# Autodesk Inventor assembly: 組合7
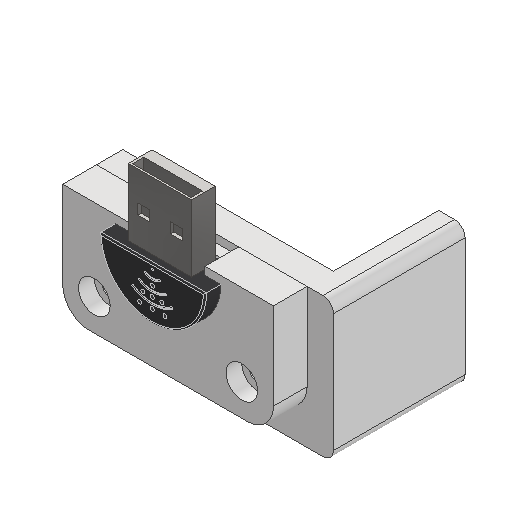
[picture p0: Inventor's stored thumbnail of the model, 512x512]
Saved by Autodesk Inventor 2027 (Build 310192060, 192F)
## iProperties
Created: 2026-11-23
Part Number: 組合7
Document SubType Name: Assembly
Designer: 王翊丞
Author: 王翊丞
## Documents named in this file (4)
- C:\Users\王翊丞\Desktop\TMrobot\voice_detect\MI-305_CAD\組合7.iam
- C:\Users\王翊丞\Desktop\TMrobot\voice_detect\MI-305_CAD\MI-305.ipt
- C:\Users\王翊丞\Desktop\TMrobot\voice_detect\MI-305_CAD\零件8.ipt
- C:\Users\王翊丞\Desktop\TMrobot\voice_detect\MI-305_CAD\零件9.ipt
## Components (3 placed, 3 different names)
1. MI-305:1 — 齊平:1, 貼合:1, 貼合:2, 貼合:3
2. 零件8:1 — 齊平:2, 貼合:1, 貼合:2, 貼合:3, 插入:1, 貼合:4
3. 零件9:1 — 插入:1, 貼合:4
## Relationships (7: Mate 4, Flush 2, Insert 1)
- 齊平:1 [Flush]: MI-305:1
- 齊平:2 [Flush]: 零件8:1
- 貼合:1 [Mate]: MI-305:1 ↔ 零件8:1
- 貼合:2 [Mate]: MI-305:1 ↔ 零件8:1
- 貼合:3 [Mate]: MI-305:1 ↔ 零件8:1
- 插入:1 [Insert]: 零件8:1 ↔ 零件9:1
- 貼合:4 [Mate]: 零件8:1 ↔ 零件9:1
